# Autodesk Inventor assembly: dtmotorsub_MIR
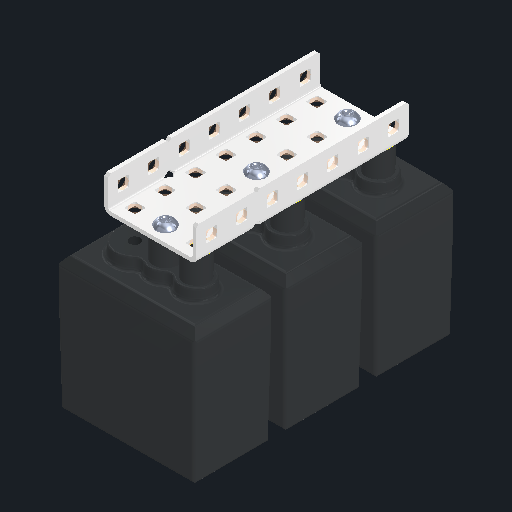
[picture p0: Inventor's stored thumbnail of the model, 512x512]
Saved by Autodesk Inventor 2026.2 (Build 302298000, 298)
## iProperties
Created: 2026-11-04
Part Number: dtmotorsub_MIR
Document SubType Name: Assembly
Designer: BuddyProject
Author: BuddyProject
## Documents named in this file (5)
- E:\593C-CAD-26-27\Mirrored Parts\dtmotorsub_MIR.iam
- E:\593C-CAD-26-27\Mirrored Parts\Alu C 1x3x1x7_MIR.ipt
- E:\593C-CAD-26-27\Mirrored Parts\V5 Simple Motor_MIR.ipt
- E:\VEX-CAD-Inventor-main\Structure\Hardware\Screw Steel - Star\SScrew Star Smooth .250.ipt
- E:\VEX-CAD-Inventor-main\Structure\Hardware\Screw Steel - Star.ipt
## Components (7 placed, 3 different names)
1. Alu C 1x3x1x7_MIR:1 — Mate:6, Mate:5, Mate:2, Mate:1, Mate:4, Mate:3, Mate:12, Mate:11, Mate:10, Mate:9, Mate:8, Mate:7
2. V5 Simple Motor_MIR:1 — Mate:6, Mate:5
3. V5 Simple Motor_MIR:2 — Mate:2, Mate:1
4. V5 Simple Motor_MIR:3 — Mate:4, Mate:3
5. SScrew Star Smooth .250:1 — Mate:12, Mate:11
6. SScrew Star Smooth .250:2 — Mate:10, Mate:9
7. SScrew Star Smooth .250:3 — Mate:8, Mate:7
## Relationships (12: Mate 12)
- Mate:6: Alu C 1x3x1x7_MIR:1 ↔ V5 Simple Motor_MIR:1
- Mate:5: Alu C 1x3x1x7_MIR:1 ↔ V5 Simple Motor_MIR:1
- Mate:2: Alu C 1x3x1x7_MIR:1 ↔ V5 Simple Motor_MIR:2
- Mate:1: Alu C 1x3x1x7_MIR:1 ↔ V5 Simple Motor_MIR:2
- Mate:4: Alu C 1x3x1x7_MIR:1 ↔ V5 Simple Motor_MIR:3
- Mate:3: Alu C 1x3x1x7_MIR:1 ↔ V5 Simple Motor_MIR:3
- Mate:12: Alu C 1x3x1x7_MIR:1 ↔ SScrew Star Smooth .250:1
- Mate:11: Alu C 1x3x1x7_MIR:1 ↔ SScrew Star Smooth .250:1
- Mate:10: Alu C 1x3x1x7_MIR:1 ↔ SScrew Star Smooth .250:2
- Mate:9: Alu C 1x3x1x7_MIR:1 ↔ SScrew Star Smooth .250:2
- Mate:8: Alu C 1x3x1x7_MIR:1 ↔ SScrew Star Smooth .250:3
- Mate:7: Alu C 1x3x1x7_MIR:1 ↔ SScrew Star Smooth .250:3
